# Autodesk Inventor assembly: 6_Ensemble
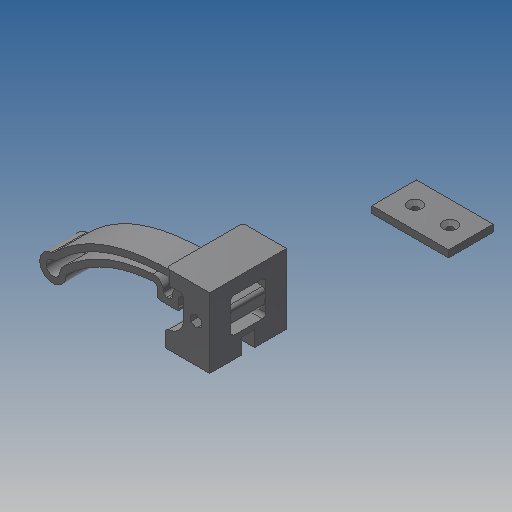
[picture p0: Inventor's stored thumbnail of the model, 512x512]
Saved by Autodesk Inventor 2025.3 (Build 293356000, 356)
## iProperties
Created: 2025-05-16
Part Number: 6_Ensemble
Project: Nom Projet
Description: Ens. Nom Ensemble
Document SubType Name: Assembly
Designer: matpo
Author: matpo
## Documents named in this file (5)
- C:\Users\matpo\OneDrive - HESSO\P2511_RVEZ\01_Robot\0101_CAO\6_Detection\6_Ensemble.iam
- C:\Users\matpo\OneDrive - HESSO\P2511_RVEZ\01_Robot\0101_CAO\6_Detection\6_01_bras_detection v7.ipt
- C:\Users\matpo\OneDrive - HESSO\P2511_RVEZ\01_Robot\0101_CAO\6_Detection\6_02_corps v5.ipt
- C:\Users\matpo\OneDrive - HESSO\P2511_RVEZ\01_Robot\0101_CAO\6_Detection\6_03_bouton v1.ipt
- C:\Users\matpo\OneDrive - HESSO\P2511_RVEZ\01_Robot\0101_CAO\6_Detection\6_04_plaque v1.ipt
## Components (4 placed, 4 different names)
1. 6_01_bras_detection v7:1 — Placage:1, Placage:2
2. 6_02_corps v5:1 — Placage:1, Placage:2, Placage:4, Placage:5, Affleurement:1
3. 6_03_bouton v1:1 — Placage:4, Placage:5, Affleurement:1
4. 6_04_plaque v1:1
## Relationships (5: Mate 4, Flush 1)
- Placage:1 [Mate]: 6_01_bras_detection v7:1 ↔ 6_02_corps v5:1
- Placage:2 [Mate] (0.2 mm): 6_01_bras_detection v7:1 ↔ 6_02_corps v5:1
- Placage:4 [Mate] (0.2 mm): 6_02_corps v5:1 ↔ 6_03_bouton v1:1
- Placage:5 [Mate]: 6_02_corps v5:1 ↔ 6_03_bouton v1:1
- Affleurement:1 [Flush]: 6_02_corps v5:1 ↔ 6_03_bouton v1:1
